# Autodesk Inventor assembly: TRALRULIMERO TRUDRILLO
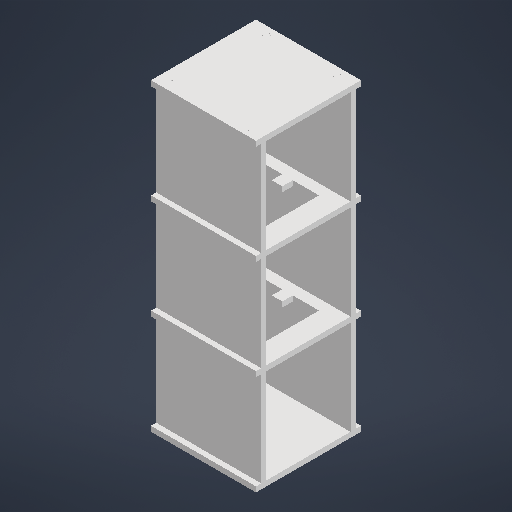
[picture p0: Inventor's stored thumbnail of the model, 512x512]
Saved by Autodesk Inventor 2025.2 (Build 292293000, 293)
## iProperties
Created: 2025-06-17
Part Number: TRALRULIMERO TRUDRILLO
Document SubType Name: Assembly
Designer: Niko
Author: Niko
## Documents named in this file (6)
- C:\Users\xxxx\OneDrive - Universidad San Sebastian\Escritorio\Elevator3000\TRALRULIMERO TRUDRILLO.iam
- C:\Users\xxxx\OneDrive - Universidad San Sebastian\Escritorio\Elevator3000\Modelar\Suelo.ipt
- C:\Users\xxxx\OneDrive - Universidad San Sebastian\Escritorio\Elevator3000\Modelar\Pared.ipt
- C:\Users\xxxx\OneDrive - Universidad San Sebastian\Escritorio\Elevator3000\Modelar\Medioreal.ipt
- C:\Users\xxxx\OneDrive - Universidad San Sebastian\Escritorio\Elevator3000\Modelar\Techo.ipt
- C:\Users\xxxx\OneDrive - Universidad San Sebastian\Escritorio\Elevator3000\Modelar\Panel.ipt
## Components (13 placed, 5 different names)
1. Suelo:1 — Rígido:1, Rígido:2
2. Pared:1 — Rígido:1
3. Pared:2 — Rígido:2, Rígido:3
4. Pared:3 — Rígido:4, Rígido:6
5. Pared:4 — Rígido:7, Rígido:9
6. Pared:5 — Rígido:5
7. Pared:6 — Rígido:8
8. Medioreal:1 — Rígido:3, Rígido:4, Rígido:5, Rígido:12
9. Medioreal:2 — Rígido:6, Rígido:7, Rígido:8, Rígido:11
10. Techo:1 — Rígido:9, Rígido:10
11. Panel:1 — Rígido:10
12. Panel:2 — Rígido:11
13. Panel:3 — Rígido:12
## Relationships (12: WeldJoint 12)
- Rígido:1 [WeldJoint]: Suelo:1 ↔ Pared:1
- Rígido:2 [WeldJoint]: Suelo:1 ↔ Pared:2
- Rígido:3 [WeldJoint]: Pared:2 ↔ Medioreal:1
- Rígido:4 [WeldJoint]: Pared:3 ↔ Medioreal:1
- Rígido:5 [WeldJoint]: Pared:5 ↔ Medioreal:1
- Rígido:6 [WeldJoint]: Pared:3 ↔ Medioreal:2
- Rígido:7 [WeldJoint]: Pared:4 ↔ Medioreal:2
- Rígido:8 [WeldJoint]: Pared:6 ↔ Medioreal:2
- Rígido:9 [WeldJoint]: Pared:4 ↔ Techo:1
- Rígido:10 [WeldJoint]: Techo:1 ↔ Panel:1
- Rígido:11 [WeldJoint]: Medioreal:2 ↔ Panel:2
- Rígido:12 [WeldJoint]: Medioreal:1 ↔ Panel:3
